# Autodesk Inventor assembly: servo_assembly
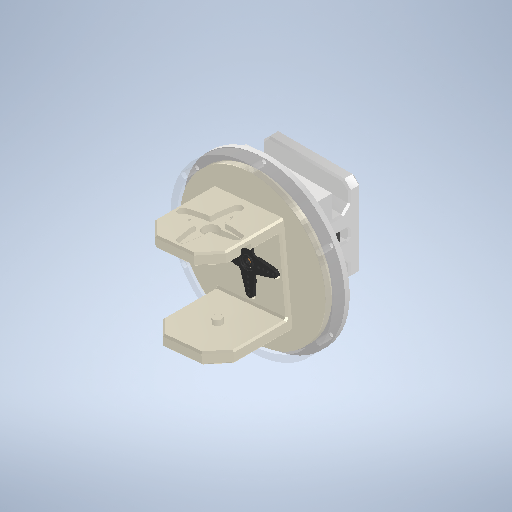
[picture p0: Inventor's stored thumbnail of the model, 512x512]
Saved by Autodesk Inventor 2025 (Build 290162000, 162)
## iProperties
Created: 2026-11-10
Part Number: servo_assembly
Document SubType Name: Assembly
Designer: diego
Author: diego
## Documents named in this file (8)
- D:\Diego\Proyectos_Diego\Halloween Hackathon\Halloween-Hackathon\CAD\out\servo_assembly.iam
- D:\Diego\Proyectos_Diego\Halloween Hackathon\Halloween-Hackathon\CAD\out\obj_1_装配体1 - 底座-1.STL.ipt
- D:\Diego\Proyectos_Diego\Halloween Hackathon\Halloween-Hackathon\CAD\out\obj_3_装配体1 - trst-1-1.STL.ipt
- D:\Diego\Proyectos_Diego\Halloween Hackathon\Halloween-Hackathon\CAD\mg-996r-servo-motor-1.snapshot.23\Parts\MG996R Motor\MG996R Motor.ipt
- D:\Diego\Proyectos_Diego\Halloween Hackathon\Halloween-Hackathon\CAD\mg-996r-servo-motor-1.snapshot.23\Parts\4-star horn\4-star horn.ipt
- D:\Diego\Proyectos_Diego\Halloween Hackathon\Halloween-Hackathon\CAD\out\retainer_lip\retainer_lip.ipt
- D:\Diego\Proyectos_Diego\Halloween Hackathon\Halloween-Hackathon\CAD\out\retainer_plate\retainer_plate.ipt
- D:\Diego\Proyectos_Diego\Halloween Hackathon\Halloween-Hackathon\CAD\out\neck_flanged.ipt
## Components (7 placed, 7 different names)
1. obj_1_装配体1 - 底座-1.STL:1 — Mate:2, Mate:11, Mate:12, Mate:13
2. obj_3_装配体1 - trst-1-1.STL:1 — Mate:5, Mate:6, Angle:1, Mate:7
3. MG996R Motor:1 — Mate:2, Mate:4, Mate:7, Mate:11, Mate:14
4. 4-star horn:1 — Mate:4, Mate:5, Mate:6, Angle:1
5. retainer_lip:1 — Mate:15, Mate:16, Mate:19, Mate:20
6. retainer_plate:1 — Mate:12, Mate:13, Mate:14, Mate:15, Mate:16, Mate:17, Mate:20
7. neck_flanged:1 — Mate:17, Mate:19
## Relationships (15: Mate 14, Angle 1)
- Mate:2: obj_1_装配体1 - 底座-1.STL:1 ↔ MG996R Motor:1
- Mate:4: MG996R Motor:1 ↔ 4-star horn:1
- Mate:5: obj_3_装配体1 - trst-1-1.STL:1 ↔ 4-star horn:1
- Mate:6: obj_3_装配体1 - trst-1-1.STL:1 ↔ 4-star horn:1
- Angle:1 (45 deg): obj_3_装配体1 - trst-1-1.STL:1 ↔ 4-star horn:1
- Mate:7: obj_3_装配体1 - trst-1-1.STL:1 ↔ MG996R Motor:1
- Mate:11: obj_1_装配体1 - 底座-1.STL:1 ↔ MG996R Motor:1
- Mate:12: obj_1_装配体1 - 底座-1.STL:1 ↔ retainer_plate:1
- Mate:13: obj_1_装配体1 - 底座-1.STL:1 ↔ retainer_plate:1
- Mate:14: MG996R Motor:1 ↔ retainer_plate:1
- Mate:15: retainer_lip:1 ↔ retainer_plate:1
- Mate:16: retainer_lip:1 ↔ retainer_plate:1
- Mate:17: retainer_plate:1 ↔ neck_flanged:1
- Mate:19: retainer_lip:1 ↔ neck_flanged:1
- Mate:20: retainer_lip:1 ↔ retainer_plate:1
